# Autodesk Inventor assembly: monotaro-bed-module
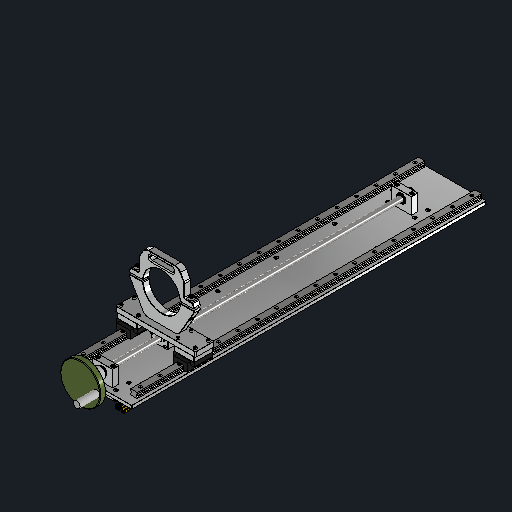
[picture p0: Inventor's stored thumbnail of the model, 512x512]
Saved by Autodesk Inventor 2027.1 (Build 311270010, 270A)
## iProperties
Created: 2026-11-14
Part Number: monotaro-bed-module
Document SubType Name: Assembly
Designer: queezz
Author: queezz
## Documents named in this file (24)
- C:\Users\queez\Dropbox\Drawings\pihti-cad\bellows-probe\monotaro-bed-module.iam
- C:\Users\queez\Dropbox\Drawings\pihti-cad\bellows-probe\Al-profile-30x30-L1000.ipt
- C:\Users\queezz\Dropbox\Drawings\pihti-cad\ContentCenter\Aluminium-profiles\Al-profile-30x30.ipt
- C:\Users\queez\Dropbox\Drawings\pihti-cad\bellows-probe\monotaro-TR16-machined-screw.ipt
- C:\Users\queez\Dropbox\Drawings\pihti-cad\bellows-probe\bearing-6001.ipt
- C:\Users\queez\Dropbox\Drawings\pihti-cad\bellows-probe\monotaro-thrust-support-block.ipt
- C:\Users\queez\Dropbox\Drawings\pihti-cad\bellows-probe\monotaro-bellows-plate.ipt
- C:\Users\queez\Dropbox\Drawings\pihti-cad\bellows-probe\SBI20-1060N-rail-envelope.ipt
- C:\Users\queez\Dropbox\Drawings\pihti-cad\bellows-probe\ASH125-bellows-wheel-envelope.ipt
- C:\Users\queez\Dropbox\Drawings\pihti-cad\bellows-probe\ASH125-bellows-grip-envelope.ipt
- C:\Users\queez\Dropbox\Drawings\pihti-cad\bellows-probe\NTN-51101-thrust-envelope.ipt
- C:\Users\queez\Dropbox\Drawings\pihti-cad\bellows-probe\monotaro-12mm-thrust-collar-envelope.ipt
- C:\Users\queez\Dropbox\Drawings\pihti-cad\bellows-probe\monotaro-TR16-end-thrust-spacer.ipt
- C:\Users\queez\Dropbox\Drawings\pihti-cad\bellows-probe\monotaro-TR16-end-retaining-washer.ipt
- C:\Users\queez\Dropbox\Drawings\pihti-cad\bellows-probe\monotaro-M5-profile-T-nut-envelope.ipt
- C:\Users\queez\Dropbox\Drawings\pihti-cad\bellows-probe\fasteners\bellows-M6x16-small-head-41519703.ipt
- C:\Users\queez\Dropbox\Drawings\pihti-cad\bellows-probe\fasteners\bellows-DIN-7991-M5x16.ipt
- C:\Users\queez\Dropbox\Drawings\pihti-cad\bellows-probe\monotaro-thrust-backing-plate.ipt
- C:\Users\queez\Dropbox\Drawings\pihti-cad\bellows-probe\fasteners\bellows-M6x75-ISO4762-class10-9.ipt
- C:\Users\queez\Dropbox\Drawings\pihti-cad\ContentCenter\Fastners\M6-18x2-Hardened-Washer.ipt
- C:\Users\queez\Dropbox\Drawings\pihti-cad\bellows-probe\fasteners\bellows-ISO-4032-M6-class10.ipt
- C:\Users\queez\Dropbox\Drawings\pihti-cad\bellows-probe\TR16-round-nut-envelope.ipt
- C:\Users\queez\Dropbox\Drawings\pihti-cad\bellows-probe\monotaro-rear-driven-carriage.iam
- C:\Users\queez\Dropbox\Drawings\pihti-cad\ContentCenter\Fastners\M5x10-SHCS.ipt
## Components (102 placed, 102 different names)
1. Al-profile-30x30-L1000:1 (carriage copy)
2. Al-profile-30x30-L1000:2 (carriage copy)
3. M16-lead-screw:1 (carriage copy)
4. bearing-6001:1 (carriage copy)
5. bearing-6001:2 (carriage copy)
6. Lead screw wheel-end block
7. Lead screw far-end block
8. MonotaRO table plate
9. Left SBC rail
10. Right SBC rail
11. IMAO ASH125 wheel envelope
12. IMAO ASH125 extended grip envelope
13. 51101 thrust at wheel end
14. 51101 thrust at vessel end
15. 12 mm split thrust collar at wheel
16. Vessel thrust spacer
17. Vessel end captive thrust washer — Retainer screw seated on captive washer
18. Thrust backing plate 1
19. Thrust backing plate 2
20. TR16 drive nut — Nut lateral location, Nut on lead screw axis, Nut captured by driven carriage
21. Rear driven carriage and flange clamp [sub-assembly] — Flush:2, Flush:3, Nut captured by driven carriage
22. M5x10 cap screw 12.9 - vessel end retainer — Retainer screw seated on captive washer
23. M6x16 low-head cap screw - rail 1
24. M6x16 low-head cap screw - rail 2
25. M6x16 low-head cap screw - rail 3
26. M6x16 low-head cap screw - rail 4
27. M6x16 low-head cap screw - rail 5
28. M6x16 low-head cap screw - rail 6
29. M6x16 low-head cap screw - rail 7
30. M6x16 low-head cap screw - rail 8
31. M6x16 low-head cap screw - rail 9
32. M6x16 low-head cap screw - rail 10
33. M6x16 low-head cap screw - rail 11
34. M6x16 low-head cap screw - rail 12
35. M6x16 low-head cap screw - rail 13
36. M6x16 low-head cap screw - rail 14
37. M6x16 low-head cap screw - rail 15
38. M6x16 low-head cap screw - rail 16
39. M6x16 low-head cap screw - rail 17
40. M6x16 low-head cap screw - rail 18
41. M6x16 low-head cap screw - rail 19
42. M6x16 low-head cap screw - rail 20
43. M6x16 low-head cap screw - rail 21
44. M6x16 low-head cap screw - rail 22
45. M6x16 low-head cap screw - rail 23
46. M6x16 low-head cap screw - rail 24
47. M6x16 low-head cap screw - rail 25
48. M6x16 low-head cap screw - rail 26
49. M6x16 low-head cap screw - rail 27
50. M6x16 low-head cap screw - rail 28
51. M6x16 low-head cap screw - rail 29
52. M6x16 low-head cap screw - rail 30
53. M6x16 low-head cap screw - rail 31
54. M6x16 low-head cap screw - rail 32
55. M6x16 low-head cap screw - rail 33
56. M6x16 low-head cap screw - rail 34
57. M6x16 low-head cap screw - rail 35
58. M6x16 low-head cap screw - rail 36
59. M5x16 flat head screw - table 1
60. M5x16 flat head screw - table 2
61. M5x16 flat head screw - table 3
62. M5x16 flat head screw - table 4
63. M5x16 flat head screw - table 5
64. M5x16 flat head screw - table 6
65. M5x16 flat head screw - table 7
66. M5x16 flat head screw - table 8
67. M5x16 flat head screw - table 9
68. M5x16 flat head screw - table 10
69. M5x16 flat head screw - table 11
70. M5x16 flat head screw - table 12
71. M6x75 cap screw 10.9 - thrust support 1
72. M6x75 cap screw 10.9 - thrust support 2
73. M6x75 cap screw 10.9 - thrust support 3
74. M6x75 cap screw 10.9 - thrust support 4
75. Profile M5 T-nut 1
76. Profile M5 T-nut 2
77. Profile M5 T-nut 3
78. Profile M5 T-nut 4
79. Profile M5 T-nut 5
80. Profile M5 T-nut 6
81. Profile M5 T-nut 7
82. Profile M5 T-nut 8
83. Profile M5 T-nut 9
84. Profile M5 T-nut 10
85. Profile M5 T-nut 11
86. Profile M5 T-nut 12
87. M5x16 flat head screw - backing plate 1
88. M5x16 flat head screw - backing plate 2
89. M5x16 flat head screw - backing plate 3
90. M5x16 flat head screw - backing plate 4
91. M5x16 flat head screw - backing plate 5
92. M5x16 flat head screw - backing plate 6
93. M5x16 flat head screw - backing plate 7
94. M5x16 flat head screw - backing plate 8
95. M6 hardened washer 6.6x18x2 - thrust 1
96. M6 nut class 10 - thrust 1
97. M6 hardened washer 6.6x18x2 - thrust 2
98. M6 nut class 10 - thrust 2
99. M6 hardened washer 6.6x18x2 - thrust 3
100. M6 nut class 10 - thrust 3
101. M6 hardened washer 6.6x18x2 - thrust 4
102. M6 nut class 10 - thrust 4
## Relationships (6: Flush 4, Mate 1, Insert 1)
- Nut lateral location [Flush]: TR16 drive nut
- Nut on lead screw axis [Mate] (-15 mm): TR16 drive nut
- Flush:2: Rear driven carriage and flange clamp
- Flush:3: Rear driven carriage and flange clamp
- Nut captured by driven carriage [Flush] (-12.5 mm): TR16 drive nut ↔ Rear driven carriage and flange clamp
- Retainer screw seated on captive washer [Insert]: Vessel end captive thrust washer ↔ M5x10 cap screw 12.9 - vessel end retainer
